# Autodesk Inventor assembly: SealOut2
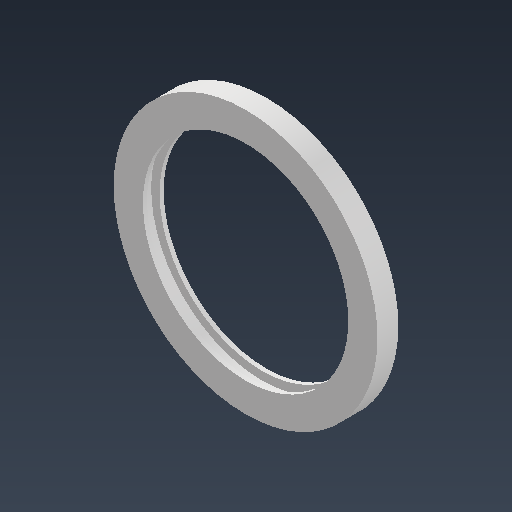
[picture p0: Inventor's stored thumbnail of the model, 512x512]
Saved by Autodesk Inventor 2025.5 (Build 295498000, 498)
## iProperties
Created: 2026-11-19
Part Number: SealOut2
Material: Steel
Document SubType Name: Assembly
Designer: Jasper Kusters
Mass: 17.6397 g
Surface Area: 110.93 cm^2
Volume: 17.6397 cm^3
Density: 1 g/cm^3
Author: Jasper Kusters
Titel: =<Titel Isah>
## iProperties of the stored document SealOut - kopie.ipt
Created: 2026-11-16
Part Number: SealOut
Material: Generic
Document SubType Name: Modeling
Designer: Gasteng5
Mass: 17.6397 g
Surface Area: 110.93 cm^2
Volume: 17.6397 cm^3
Density: 1 g/cm^3
Appearance: Default
Author: Gasteng5
Sending System: Autodesk Inventor 2027
## Documents named in this file (3)
- **C:\Users\Gasteng5\Documents\ilogic2027\Seals\Inventor2025\SealOut2.iam*LocalDocs*xAaaaamdaAaaaaaaaAaaaqdzhNe*SealOut - kopie.ipt
- C:\Users\Gasteng5\Documents\ilogic2027\Seals\Inventor2025\SealOut2.iam
- C:\Users\Gasteng5\Documents\ilogic2027\Seals\Parts\SealOut - kopie.ipt
## Components (1 placed, 1 different names)
1. SealOut - kopie:1 — Mate:1, Mate:2, Flush:1
## Relationships (3: Mate 2, Flush 1)
- Mate:1: SealOut - kopie:1
- Mate:2: SealOut - kopie:1
- Flush:1: SealOut - kopie:1
